# Autodesk Inventor assembly: Assembly_tft
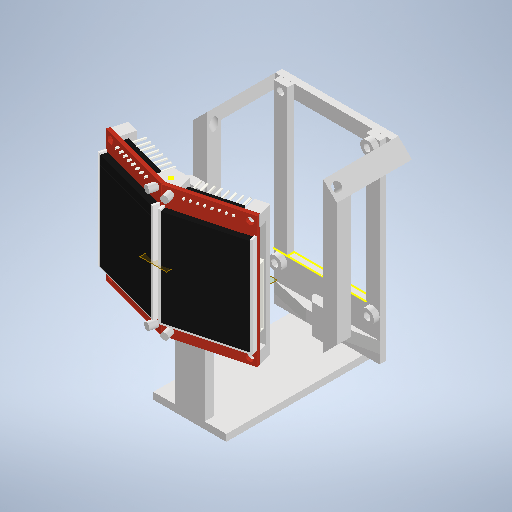
[picture p0: Inventor's stored thumbnail of the model, 512x512]
Saved by Autodesk Inventor 2025 (Build 290162000, 162)
## iProperties
Created: 2026-10-26
Part Number: Assembly_tft
Document SubType Name: Assembly
Designer: diego
Author: diego
## Documents named in this file (6)
- D:\Diego\Proyectos_Diego\Halloween Hackathon\Halloween-Hackathon\CAD\Assembly_tft.iam
- C:\Users\diego\Downloads\LCD_TFT_1.8_v3.ipt
- D:\Diego\Proyectos_Diego\Halloween Hackathon\Halloween-Hackathon\CAD\Support_tft.ipt
- D:\Diego\Proyectos_Diego\Halloween Hackathon\Halloween-Hackathon\CAD\3Dprint\Support_base.ipt
- D:\Diego\Proyectos_Diego\Halloween Hackathon\Halloween-Hackathon\CAD\3Dprint\Support_pcb.ipt
- D:\Diego\Proyectos_Diego\Halloween Hackathon\Halloween-Hackathon\CAD\3Dprint\Support_leds.ipt
## Components (6 placed, 5 different names)
1. LCD_TFT_1.8_v3:1 — Angle:1, Flush:3, Angle:3, Mate:1, Mate:11
2. LCD_TFT_1.8_v3:2 — Angle:2, Flush:3, Angle:3, Mate:1, Mate:10
3. Support_tft:1 — Flush:4, Flush:5, Mate:10, Mate:11, Mate:12, Mate:13
4. Support_base:1 — Flush:4, Flush:5, Mate:12, Mate:13, Mate:15, Mate:16
5. Support_pcb:1 — Mate:4, Mate:7, Mate:8, Mate:9, Mate:15, Mate:16
6. Support_leds:1 — Mate:7, Mate:8, Mate:9
## Relationships (17: Mate 11, Angle 3, Flush 3)
- Angle:1 (180 deg): LCD_TFT_1.8_v3:1
- Angle:2 (180 deg): LCD_TFT_1.8_v3:2
- Flush:3: LCD_TFT_1.8_v3:1 ↔ LCD_TFT_1.8_v3:2
- Angle:3 (150 deg): LCD_TFT_1.8_v3:1 ↔ LCD_TFT_1.8_v3:2
- Mate:1: LCD_TFT_1.8_v3:1 ↔ LCD_TFT_1.8_v3:2
- Flush:4: Support_tft:1 ↔ Support_base:1
- Flush:5: Support_tft:1 ↔ Support_base:1
- Mate:4: Support_pcb:1
- Mate:7: Support_pcb:1 ↔ Support_leds:1
- Mate:8: Support_pcb:1 ↔ Support_leds:1
- Mate:9: Support_pcb:1 ↔ Support_leds:1
- Mate:10: LCD_TFT_1.8_v3:2 ↔ Support_tft:1
- Mate:11: LCD_TFT_1.8_v3:1 ↔ Support_tft:1
- Mate:12: Support_tft:1 ↔ Support_base:1
- Mate:13: Support_tft:1 ↔ Support_base:1
- Mate:15: Support_base:1 ↔ Support_pcb:1
- Mate:16: Support_base:1 ↔ Support_pcb:1
